# Autodesk Inventor assembly: Complete System Assembly V2
Saved by Autodesk Inventor 2026 (Build 300175000, 175)
## iProperties
Created: 2026-03-04
Part Number: Complete System Assembly V2
Document SubType Name: Assembly
Designer: FiolkaLab
Author: FiolkaLab
## Documents named in this file (6)
- E:\Muaaz\Baseplate\ASLM_DvOPM System Assembly\Complete System Assembly V2.iam
- E:\Muaaz\Baseplate\ASLM_DvOPM System Assembly\T46HK-Step\T46HK-Step\T46HK-Step.ipt
- E:\Muaaz\Baseplate\ASLM_DvOPM System Assembly\Stage Assembly 263mm H.ipt
- E:\Muaaz\Baseplate\ASLM_DvOPM System Assembly\Detection Aseembly with Stages.iam
- E:\Muaaz\Baseplate\Illumination\Illumination Assembly with Posts.iam
- E:\Muaaz\Baseplate\ASLM_DvOPM System Assembly\Sample Holder.iam
## Components (5 placed, 5 different names)
1. T46HK-Step:1 — Mate:1, Mate:2, Angle:2, Mate:4, Mate:5, Angle:3, Mate:11, Mate:12, Mate:13, Flush:2
2. Stage Assembly 263mm H:1 — Mate:1, Mate:2, Mate:8, Mate:9, Mate:10
3. Detection Aseembly with Stages:1 [sub-assembly] — Angle:2, Mate:4, Mate:5
4. Illumination Assembly with Posts:1 [sub-assembly] — Angle:3, Mate:11, Mate:12, Mate:14
5. Sample Holder:1 [sub-assembly] — Mate:8, Mate:9, Mate:10, Angle:4, Angle:5
## Relationships (17: Mate 11, Angle 4, Flush 2)
- Mate:1: T46HK-Step:1 ↔ Stage Assembly 263mm H:1
- Mate:2: T46HK-Step:1 ↔ Stage Assembly 263mm H:1
- Angle:2 (0 deg): T46HK-Step:1 ↔ Detection Aseembly with Stages:1
- Mate:4: T46HK-Step:1 ↔ Detection Aseembly with Stages:1
- Mate:5: T46HK-Step:1 ↔ Detection Aseembly with Stages:1
- Angle:3 (0 deg): T46HK-Step:1 ↔ Illumination Assembly with Posts:1
- Mate:8: Stage Assembly 263mm H:1 ↔ Sample Holder:1
- Mate:9: Stage Assembly 263mm H:1 ↔ Sample Holder:1
- Mate:10: Stage Assembly 263mm H:1 ↔ Sample Holder:1
- Mate:11: T46HK-Step:1 ↔ Illumination Assembly with Posts:1
- Mate:12: T46HK-Step:1 ↔ Illumination Assembly with Posts:1
- Mate:13: T46HK-Step:1
- Angle:4 (-20 deg): Sample Holder:1
- Flush:1 (-585.47 mm)
- Mate:14: Illumination Assembly with Posts:1
- Angle:5 (20 deg): Sample Holder:1
- Flush:2 (258 mm): T46HK-Step:1
